# Autodesk Inventor assembly: SCARA_3_v1
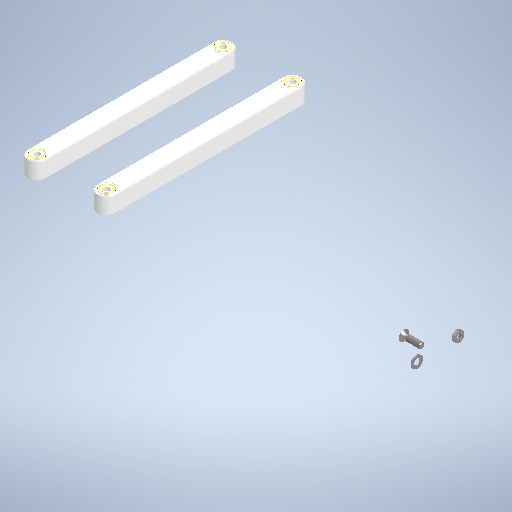
[picture p0: Inventor's stored thumbnail of the model, 512x512]
Saved by Autodesk Inventor 2025.1 (Build 291241000, 241)
## iProperties
Created: 2026-10-14
Part Number: SCARA_3_v1
Document SubType Name: Assembly
Designer: Ваня
Author: Ваня
## Documents named in this file (6)
- C:\Users\Ваня\Desktop\SCARA_ETZ_2027\3D Модели\Сборки\SCARA_3_v1.iam
- C:\Users\Ваня\Desktop\SCARA_ETZ_2027\3D Модели\Для печати\Плечо_переднее.ipt
- C:\Users\Ваня\Desktop\SCARA_ETZ_2027\3D Модели\Для сборки\Подшипники\605-ZZ.ipt
- C:\Users\Ваня\Documents\Inventor\Content Center Files\R2025\ru-RU\AS 1474(1)\AS 1474 - M5(1).ipt
- C:\Users\Ваня\Documents\Inventor\Content Center Files\R2025\ru-RU\AS 1427(07)\AS 1427 - M5 x 16(6) II.ipt
- C:\Users\Ваня\Documents\Inventor\Content Center Files\R2025\ru-RU\AS 1237 (4.1)\AS 1237 - 5 mm(2).ipt
## Components (12 placed, 5 different names)
1. Плечо_переднее:2 — Жесткий:1, Жесткий:2, Жесткий:3, Жесткий:4
2. 605-ZZ:1 — Жесткий:1
3. 605-ZZ:3 — Жесткий:2
4. 605-ZZ:4 — Жесткий:4
5. 605-ZZ:5 — Жесткий:3
6. Плечо_переднее:4
7. 605-ZZ:10
8. 605-ZZ:11
9. 605-ZZ:13
10. AS 1474 - метрическая M5:1
11. AS 1427 Z - метрическая M5 x 16:1
12. AS 1237 (4.1) 5 mm:1
## Relationships (7: WeldJoint 7)
- Жесткий:1 [WeldJoint]: Плечо_переднее:2 ↔ 605-ZZ:1
- Жесткий:2 [WeldJoint]: Плечо_переднее:2 ↔ 605-ZZ:3
- Жесткий:3 [WeldJoint]: Плечо_переднее:2 ↔ 605-ZZ:5
- Жесткий:4 [WeldJoint]: Плечо_переднее:2 ↔ 605-ZZ:4
- [WeldJoint]: Плечо_переднее:4 ↔ 605-ZZ:10
- [WeldJoint]: Плечо_переднее:4 ↔ 605-ZZ:11
- [WeldJoint]: Плечо_переднее:4 ↔ 605-ZZ:13
## Named parameters: d10_d0 = 0 mm, d11_d3 = 0 mm, d12_d4 = 0 mm
